# Autodesk Inventor assembly: base-roter
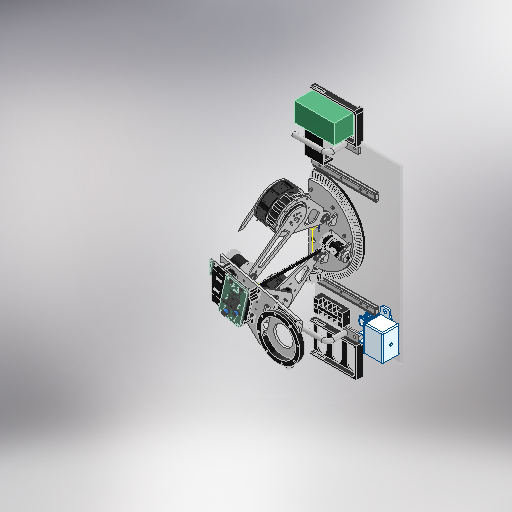
[picture p0: Inventor's stored thumbnail of the model, 512x512]
Saved by Autodesk Inventor 2025.3 (Build 293356030, 356C)
## iProperties
Created: 2026-02-11
Part Number: base-roter
Document SubType Name: Assembly
Designer: ibuki_ono
Author: ibuki_ono
## Documents named in this file (35)
- C:\Users\ibuki_ono\Documents\hobby\rogiken\catchrobo\2026_CAD\Hardware_2026\Inventor\base_table\base-roter.iam
- C:\Users\ibuki_ono\Documents\hobby\rogiken\catchrobo\2026_CAD\Hardware_2026\Inventor\base_table\gear\umbrella.iam
- C:\Users\ibuki_ono\Documents\hobby\rogiken\catchrobo\2026_CAD\Hardware_2026\Inventor\base_table\table_arm.iam
- C:\Users\ibuki_ono\Documents\hobby\rogiken\catchrobo\2026_CAD\Hardware_2026\Inventor\base_table\TOK_BEARING_101013DH16B1\101013 DH-16-B1.iam
- C:\Users\ibuki_ono\Documents\hobby\rogiken\catchrobo\2026_CAD\Hardware_2026\Inventor\base_table\AP5.0_base-roter.ipt
- C:\Users\ibuki_ono\Documents\hobby\rogiken\catchrobo\2026_CAD\Hardware_2026\Inventor\base_table\FL688ZZ.ipt
- C:\Users\ibuki_ono\Documents\hobby\rogiken\catchrobo\2026_CAD\Hardware_2026\Inventor\base_table\AP5.0_base-bearing-fix.ipt
- C:\Users\ibuki_ono\Documents\hobby\rogiken\catchrobo\2026_CAD\Hardware_2026\Inventor\base_table\AP5.0_motor-base.ipt
- C:\Users\ibuki_ono\Documents\hobby\rogiken\catchrobo\2026_CAD\Hardware_2026\Inventor\base_table\3D_GIM-fix.ipt
- C:\Users\ibuki_ono\Documents\hobby\rogiken\catchrobo\2026_CAD\Hardware_2026\Inventor\base_table\base_plate.ipt
- C:\Users\ibuki_ono\Documents\hobby\rogiken\catchrobo\2026_CAD\Hardware_2026\Inventor\base_table\AP2.0_base-roter-housing.ipt
- C:\Users\ibuki_ono\Documents\hobby\rogiken\catchrobo\2026_CAD\Hardware_2026\Inventor\base_table\AP5.0_base-bearing-fix-long.ipt
- C:\Users\ibuki_ono\Documents\hobby\rogiken\catchrobo\2026_CAD\Hardware_2026\Inventor\base_table\3D_outer-gear.ipt
- C:\Users\ibuki_ono\Documents\hobby\rogiken\catchrobo\2026_CAD\Hardware_2026\Inventor\base_table\AP10.0_com.ipt
- C:\Users\ibuki_ono\Documents\hobby\rogiken\catchrobo\2026_CAD\Hardware_2026\Inventor\base_table\UDP_w5500\UDP_w5500\UDP_w5500.iam
- C:\Users\ibuki_ono\Documents\hobby\rogiken\catchrobo\2026_CAD\Hardware_2026\Inventor\base_table\AS5600\AS5600.ipt
- C:\Users\ibuki_ono\Documents\hobby\rogiken\catchrobo\2026_CAD\Hardware_2026\Inventor\base_table\3D_roter-encoder.ipt
- C:\Users\ibuki_ono\Documents\hobby\rogiken\catchrobo\2026_CAD\Hardware_2026\Inventor\circuit\TE_relay.ipt
- C:\Users\ibuki_ono\Documents\hobby\rogiken\catchrobo\2026_CAD\Hardware_2026\Inventor\circuit\LiPo6cell.ipt
- C:\Users\ibuki_ono\Documents\hobby\rogiken\catchrobo\2026_CAD\Hardware_2026\Inventor\base_table\C-SRY20250\C-SRY20250.iam
- C:\Users\ibuki_ono\Documents\hobby\rogiken\catchrobo\2026_CAD\Hardware_2026\Inventor\circuit\IntelRealsense_D435_Multibody\IntelRealsense_D435_Multibody\IntelRealsense_D435_Multibody.ipt
- C:\Users\ibuki_ono\Documents\hobby\rogiken\catchrobo\2026_CAD\Hardware_2026\Inventor\base_table\AP3.0_E-STOP-camera.ipt
- C:\Users\ibuki_ono\Documents\hobby\rogiken\catchrobo\2026_CAD\Hardware_2026\Inventor\circuit\EmergencyStop.ipt
- C:\Users\ibuki_ono\Documents\hobby\rogiken\catchrobo\2026_CAD\Hardware_2026\Inventor\base_table\3D_Estop-mount.ipt
- C:\Users\ibuki_ono\Documents\hobby\rogiken\catchrobo\2026_CAD\Hardware_2026\Inventor\circuit\terminal.ipt
- C:\Users\ibuki_ono\Documents\hobby\rogiken\catchrobo\2026_CAD\Hardware_2026\Inventor\base_table\RoboMaster M2006 P36直流无刷减速电机\RoboMaster M2006 P36直流无刷减速电机.ipt
- C:\Users\ibuki_ono\Documents\hobby\rogiken\catchrobo\2026_CAD\Hardware_2026\Inventor\base_table\AP5.0_robomaster-fix.ipt
- C:\Users\ibuki_ono\Documents\hobby\rogiken\catchrobo\2026_CAD\Hardware_2026\Inventor\base_table\AP5.0_D-fix-A.ipt
- C:\Users\ibuki_ono\Documents\hobby\rogiken\catchrobo\2026_CAD\Hardware_2026\Inventor\base_table\3D_LiPo-holder.ipt
- C:\Users\ibuki_ono\Documents\hobby\rogiken\catchrobo\2026_CAD\Hardware_2026\Inventor\base_table\carbon-fai10-330mm.ipt
- C:\Users\ibuki_ono\Documents\hobby\rogiken\catchrobo\2026_CAD\Hardware_2026\Inventor\base_table\3D_carbon_mount-base.ipt
- C:\Users\ibuki_ono\Documents\hobby\rogiken\catchrobo\2026_CAD\Hardware_2026\Inventor\base_table\3D_realsense-mount.ipt
- C:\Users\ibuki_ono\Documents\hobby\rogiken\catchrobo\2026_CAD\Hardware_2026\Inventor\base_table\3D_circuit-mount.ipt
- C:\Users\ibuki_ono\Documents\hobby\rogiken\catchrobo\2026_CAD\Hardware_2026\Inventor\base_table\UWANSS160_Inventor\UWANSS160.ipt
- C:\Users\ibuki_ono\Documents\hobby\rogiken\catchrobo\2026_CAD\Hardware_2026\Inventor\base_table\3D_LAN-switch.ipt
## Components (62 placed, 34 different names)
1. umbrella:1 [sub-assembly] — メイト:17, 挿入:56, 挿入:57, メイト:27, 挿入:66, 挿入:67
2. 101013 DH-16-B1:1 [sub-assembly] — 挿入:6
3. 101013 DH-16-B1:2 [sub-assembly] — 挿入:5
4. AP5.0_base-roter:1 — 挿入:5, 挿入:6, 挿入:7, 挿入:8, 挿入:11, 挿入:12, 挿入:17, 挿入:18, 挿入:19, 挿入:20, 挿入:41, 挿入:42, 挿入:43, 挿入:44, 挿入:45, 挿入:46, メイト:17, 角度:1, 挿入:75, 挿入:76, 挿入:89, 挿入:90
5. AP5.0_base-bearing-fix:1 — 挿入:7, 挿入:8, メイト:14, 挿入:55
6. AP5.0_base-bearing-fix:2 — 挿入:11, 挿入:12
7. AP5.0_base-bearing-fix:3 — 挿入:17, 挿入:18, メイト:13
8. AP5.0_base-bearing-fix:4 — 挿入:19, 挿入:20
9. table_arm:3 [sub-assembly] — 挿入:31, 挿入:32, 挿入:33, 挿入:34, 挿入:65
10. FL688ZZ:7 — 挿入:32, メイト:26
11. FL688ZZ:8 — 挿入:34, メイト:14, 挿入:55
12. FL688ZZ:9 — 挿入:31, メイト:20, 挿入:62
13. FL688ZZ:10 — 挿入:33
14. table_arm:4 [sub-assembly] — メイト:24, 挿入:64
15. FL688ZZ:11
16. FL688ZZ:12 — メイト:13
17. FL688ZZ:13 — メイト:19, 挿入:63
18. FL688ZZ:14
19. 101013 DH-16-B1:5 [sub-assembly] — 挿入:41
20. 101013 DH-16-B1:6 [sub-assembly] — 挿入:42, メイト:18, 正接:1
21. 101013 DH-16-B1:7 [sub-assembly] — 挿入:43
22. 101013 DH-16-B1:8 [sub-assembly] — 挿入:45
23. 101013 DH-16-B1:9 [sub-assembly] — 挿入:46, 正接:2
24. 101013 DH-16-B1:10 [sub-assembly] — 挿入:44
25. AP5.0_motor-base:1 — 挿入:51, 挿入:52, 挿入:53, 挿入:54, 挿入:58, 挿入:59, 挿入:60, 挿入:61, 角度:1, 挿入:115, 挿入:116
26. 3D_GIM-fix:1 — 挿入:53, 挿入:54
27. 3D_GIM-fix:2 — 挿入:51, 挿入:52
28. base_plate:1 — メイト:27, 挿入:66, 挿入:67, 挿入:68, 挿入:69, 挿入:70, 挿入:71, メイト:28, メイト:29, フラッシュ:1, 挿入:77, 挿入:78, メイト:35, 挿入:81, 挿入:82, 挿入:83, 挿入:84, メイト:36, 角度:3, 挿入:111, 挿入:112, 挿入:113, 挿入:114, 挿入:121, 挿入:122, 挿入:125, 挿入:126
29. AP2.0_base-roter-housing:1 — メイト:18, 正接:1, 正接:2, 挿入:56, 挿入:57
30. AP5.0_base-bearing-fix-long:1 — 挿入:58, 挿入:59, メイト:19, メイト:22, 挿入:63
31. AP5.0_base-bearing-fix-long:2 — 挿入:60, 挿入:61, メイト:20, 挿入:62
32. 3D_outer-gear:2 — メイト:22, メイト:24, 挿入:64
33. 3D_outer-gear:3 — メイト:26, 挿入:65
34. AP10.0_com:1 — 挿入:68, 挿入:69
35. AP10.0_com:2 — 挿入:70, 挿入:71
36. AS5600:1 — 挿入:75, 挿入:76
37. 3D_roter-encoder:1 — 挿入:77, 挿入:78
38. TE_relay:1 — メイト:35, 挿入:111, 挿入:112
39. C-SRY20250:1 [sub-assembly] — 挿入:81, 挿入:82
40. C-SRY20250:2 [sub-assembly] — 挿入:83, 挿入:84, 挿入:85, 角度:2
41. IntelRealsense_D435_Multibody:1 — 挿入:109, 挿入:110
42. AP3.0_E-STOP-camera:1 — 挿入:85, 角度:2, 挿入:86, 挿入:87, 挿入:101, 挿入:102, 挿入:104, 挿入:105
43. EmergencyStop:1 — 挿入:88
44. 3D_Estop-mount:1 — 挿入:86, 挿入:87, 挿入:88
45. LiPo6cell:1 — メイト:39, メイト:40, メイト:41
46. terminal:1 — メイト:36, 角度:3, 挿入:113, 挿入:114
47. RoboMaster M2006 P36直流无刷减速电机:1 — 挿入:91, 挿入:92, メイト:37, メイト:38
48. AP5.0_robomaster-fix:1 — 挿入:89, 挿入:90, 挿入:91, 挿入:92
49. AP5.0_D-fix-A:1 — メイト:37, メイト:38
50. 3D_LiPo-holder:1 — メイト:39, メイト:40, メイト:41, 挿入:127, 挿入:128
51. 3D_LiPo-holder:2 — 挿入:121, 挿入:122, 挿入:123, 挿入:124
52. carbon-fai10-330mm:1 — 挿入:106, 挿入:108
53. carbon-fai10-330mm:2 — 挿入:103, 挿入:107
54. 3D_carbon_mount-base:1 — 挿入:101, 挿入:102, 挿入:103
55. 3D_carbon_mount-base:2 — 挿入:104, 挿入:105, 挿入:106
56. 3D_realsense-mount:1 — 挿入:107, 挿入:108, 挿入:109, 挿入:110
57. UDP_w5500:1 [sub-assembly] — 挿入:117, 挿入:118
58. 3D_circuit-mount:1 — 挿入:115, 挿入:116, 挿入:117, 挿入:118, 挿入:119, 挿入:120
59. UDP_w5500:2 [sub-assembly] — 挿入:119, 挿入:120
60. UWANSS160:1 — 挿入:123, 挿入:124
61. 3D_LAN-switch:1 — 挿入:125, 挿入:126
62. UWANSS160:2 — 挿入:127, 挿入:128
## Relationships (114: Insert 89, Mate 19, Angle 3, Tangent 2, Flush 1)
- 挿入:5 [Insert]: 101013 DH-16-B1:2 ↔ AP5.0_base-roter:1
- 挿入:6 [Insert]: 101013 DH-16-B1:1 ↔ AP5.0_base-roter:1
- 挿入:7 [Insert]: AP5.0_base-roter:1 ↔ AP5.0_base-bearing-fix:1
- 挿入:8 [Insert]: AP5.0_base-roter:1 ↔ AP5.0_base-bearing-fix:1
- 挿入:11 [Insert]: AP5.0_base-roter:1 ↔ AP5.0_base-bearing-fix:2
- 挿入:12 [Insert]: AP5.0_base-roter:1 ↔ AP5.0_base-bearing-fix:2
- 挿入:17 [Insert]: AP5.0_base-roter:1 ↔ AP5.0_base-bearing-fix:3
- 挿入:18 [Insert]: AP5.0_base-roter:1 ↔ AP5.0_base-bearing-fix:3
- 挿入:19 [Insert]: AP5.0_base-roter:1 ↔ AP5.0_base-bearing-fix:4
- 挿入:20 [Insert]: AP5.0_base-roter:1 ↔ AP5.0_base-bearing-fix:4
- 挿入:31 [Insert]: table_arm:3 ↔ FL688ZZ:9
- 挿入:32 [Insert]: table_arm:3 ↔ FL688ZZ:7
- 挿入:33 [Insert]: table_arm:3 ↔ FL688ZZ:10
- 挿入:34 [Insert]: table_arm:3 ↔ FL688ZZ:8
- [Insert]: table_arm:4 ↔ FL688ZZ:13
- [Insert]: table_arm:4 ↔ FL688ZZ:11
- [Insert]: table_arm:4 ↔ FL688ZZ:14
- [Insert]: table_arm:4 ↔ FL688ZZ:12
- メイト:13 [Mate]: AP5.0_base-bearing-fix:3 ↔ FL688ZZ:12
- メイト:14 [Mate]: AP5.0_base-bearing-fix:1 ↔ FL688ZZ:8
- 挿入:41 [Insert]: AP5.0_base-roter:1 ↔ 101013 DH-16-B1:5
- 挿入:42 [Insert]: AP5.0_base-roter:1 ↔ 101013 DH-16-B1:6
- 挿入:43 [Insert]: AP5.0_base-roter:1 ↔ 101013 DH-16-B1:7
- 挿入:44 [Insert]: AP5.0_base-roter:1 ↔ 101013 DH-16-B1:10
- 挿入:45 [Insert]: AP5.0_base-roter:1 ↔ 101013 DH-16-B1:8
- 挿入:46 [Insert]: AP5.0_base-roter:1 ↔ 101013 DH-16-B1:9
- 挿入:51 [Insert]: AP5.0_motor-base:1 ↔ 3D_GIM-fix:2
- 挿入:52 [Insert]: AP5.0_motor-base:1 ↔ 3D_GIM-fix:2
- 挿入:53 [Insert]: AP5.0_motor-base:1 ↔ 3D_GIM-fix:1
- 挿入:54 [Insert]: AP5.0_motor-base:1 ↔ 3D_GIM-fix:1
- 挿入:55 [Insert] (6.5 mm): AP5.0_base-bearing-fix:1 ↔ FL688ZZ:8
- メイト:17 [Mate]: umbrella:1 ↔ AP5.0_base-roter:1
- メイト:18 [Mate] (0.05 mm): 101013 DH-16-B1:6 ↔ AP2.0_base-roter-housing:1
- 正接:1 [Tangent]: 101013 DH-16-B1:6 ↔ AP2.0_base-roter-housing:1
- 正接:2 [Tangent]: 101013 DH-16-B1:9 ↔ AP2.0_base-roter-housing:1
- 挿入:56 [Insert]: umbrella:1 ↔ AP2.0_base-roter-housing:1
- 挿入:57 [Insert]: umbrella:1 ↔ AP2.0_base-roter-housing:1
- 挿入:58 [Insert]: AP5.0_motor-base:1 ↔ AP5.0_base-bearing-fix-long:1
- 挿入:59 [Insert]: AP5.0_motor-base:1 ↔ AP5.0_base-bearing-fix-long:1
- メイト:19 [Mate]: FL688ZZ:13 ↔ AP5.0_base-bearing-fix-long:1
- 挿入:60 [Insert]: AP5.0_motor-base:1 ↔ AP5.0_base-bearing-fix-long:2
- 挿入:61 [Insert]: AP5.0_motor-base:1 ↔ AP5.0_base-bearing-fix-long:2
- メイト:20 [Mate]: FL688ZZ:9 ↔ AP5.0_base-bearing-fix-long:2
- 挿入:62 [Insert] (0.2 mm): FL688ZZ:9 ↔ AP5.0_base-bearing-fix-long:2
- メイト:22 [Mate]: AP5.0_base-bearing-fix-long:1 ↔ 3D_outer-gear:2
- メイト:24 [Mate]: table_arm:4 ↔ 3D_outer-gear:2
- 角度:1 [Angle] (0 deg): AP5.0_base-roter:1 ↔ AP5.0_motor-base:1
- 挿入:63 [Insert] (0.2 mm): FL688ZZ:13 ↔ AP5.0_base-bearing-fix-long:1
- 挿入:64 [Insert]: table_arm:4 ↔ 3D_outer-gear:2
- メイト:26 [Mate]: FL688ZZ:7 ↔ 3D_outer-gear:3
- 挿入:65 [Insert]: table_arm:3 ↔ 3D_outer-gear:3
- メイト:27 [Mate]: umbrella:1 ↔ base_plate:1
- 挿入:66 [Insert]: umbrella:1 ↔ base_plate:1
- 挿入:67 [Insert]: umbrella:1 ↔ base_plate:1
- 挿入:68 [Insert]: base_plate:1 ↔ AP10.0_com:1
- 挿入:69 [Insert]: base_plate:1 ↔ AP10.0_com:1
- 挿入:70 [Insert]: base_plate:1 ↔ AP10.0_com:2
- 挿入:71 [Insert]: base_plate:1 ↔ AP10.0_com:2
- メイト:28 [Mate]: base_plate:1
- メイト:29 [Mate]: base_plate:1
- フラッシュ:1 [Flush]: base_plate:1
- 挿入:75 [Insert] (2 mm): AP5.0_base-roter:1 ↔ AS5600:1
- 挿入:76 [Insert] (2 mm): AP5.0_base-roter:1 ↔ AS5600:1
- 挿入:77 [Insert]: base_plate:1 ↔ 3D_roter-encoder:1
- 挿入:78 [Insert]: base_plate:1 ↔ 3D_roter-encoder:1
- メイト:35 [Mate]: base_plate:1 ↔ TE_relay:1
- 挿入:81 [Insert]: base_plate:1 ↔ C-SRY20250:1
- 挿入:82 [Insert]: base_plate:1 ↔ C-SRY20250:1
- 挿入:83 [Insert]: base_plate:1 ↔ C-SRY20250:2
- 挿入:84 [Insert]: base_plate:1 ↔ C-SRY20250:2
- 挿入:85 [Insert]: C-SRY20250:2 ↔ AP3.0_E-STOP-camera:1
- 角度:2 [Angle] (-90 deg): C-SRY20250:2 ↔ AP3.0_E-STOP-camera:1
- 挿入:86 [Insert]: AP3.0_E-STOP-camera:1 ↔ 3D_Estop-mount:1
- 挿入:87 [Insert]: AP3.0_E-STOP-camera:1 ↔ 3D_Estop-mount:1
- 挿入:88 [Insert]: EmergencyStop:1 ↔ 3D_Estop-mount:1
- メイト:36 [Mate]: base_plate:1 ↔ terminal:1
- 挿入:89 [Insert]: AP5.0_base-roter:1 ↔ AP5.0_robomaster-fix:1
- 挿入:90 [Insert]: AP5.0_base-roter:1 ↔ AP5.0_robomaster-fix:1
- 挿入:91 [Insert]: RoboMaster M2006 P36直流无刷减速电机:1 ↔ AP5.0_robomaster-fix:1
- 挿入:92 [Insert]: RoboMaster M2006 P36直流无刷减速电机:1 ↔ AP5.0_robomaster-fix:1
- メイト:37 [Mate]: RoboMaster M2006 P36直流无刷减速电机:1 ↔ AP5.0_D-fix-A:1
- メイト:38 [Mate]: RoboMaster M2006 P36直流无刷减速电机:1 ↔ AP5.0_D-fix-A:1
- メイト:39 [Mate]: LiPo6cell:1 ↔ 3D_LiPo-holder:1
- メイト:40 [Mate] (8 mm): LiPo6cell:1 ↔ 3D_LiPo-holder:1
- メイト:41 [Mate] (12 mm): LiPo6cell:1 ↔ 3D_LiPo-holder:1
- 挿入:101 [Insert]: AP3.0_E-STOP-camera:1 ↔ 3D_carbon_mount-base:1
- 挿入:102 [Insert]: AP3.0_E-STOP-camera:1 ↔ 3D_carbon_mount-base:1
- 挿入:103 [Insert]: carbon-fai10-330mm:2 ↔ 3D_carbon_mount-base:1
- 挿入:104 [Insert]: AP3.0_E-STOP-camera:1 ↔ 3D_carbon_mount-base:2
- 挿入:105 [Insert]: AP3.0_E-STOP-camera:1 ↔ 3D_carbon_mount-base:2
- 挿入:106 [Insert]: carbon-fai10-330mm:1 ↔ 3D_carbon_mount-base:2
- 挿入:107 [Insert]: carbon-fai10-330mm:2 ↔ 3D_realsense-mount:1
- 挿入:108 [Insert]: carbon-fai10-330mm:1 ↔ 3D_realsense-mount:1
- 挿入:109 [Insert]: IntelRealsense_D435_Multibody:1 ↔ 3D_realsense-mount:1
- 挿入:110 [Insert]: IntelRealsense_D435_Multibody:1 ↔ 3D_realsense-mount:1
- 角度:3 [Angle] (90 deg): base_plate:1 ↔ terminal:1
- 挿入:111 [Insert]: base_plate:1 ↔ TE_relay:1
- 挿入:112 [Insert]: base_plate:1 ↔ TE_relay:1
- 挿入:113 [Insert]: base_plate:1 ↔ terminal:1
- 挿入:114 [Insert]: base_plate:1 ↔ terminal:1
- 挿入:115 [Insert]: AP5.0_motor-base:1 ↔ 3D_circuit-mount:1
- 挿入:116 [Insert]: AP5.0_motor-base:1 ↔ 3D_circuit-mount:1
- 挿入:117 [Insert]: UDP_w5500:1 ↔ 3D_circuit-mount:1
- 挿入:118 [Insert]: UDP_w5500:1 ↔ 3D_circuit-mount:1
- 挿入:119 [Insert]: 3D_circuit-mount:1 ↔ UDP_w5500:2
- 挿入:120 [Insert]: 3D_circuit-mount:1 ↔ UDP_w5500:2
- 挿入:121 [Insert]: base_plate:1 ↔ 3D_LiPo-holder:2
- 挿入:122 [Insert]: base_plate:1 ↔ 3D_LiPo-holder:2
- 挿入:123 [Insert]: 3D_LiPo-holder:2 ↔ UWANSS160:1
- 挿入:124 [Insert]: 3D_LiPo-holder:2 ↔ UWANSS160:1
- 挿入:125 [Insert]: base_plate:1 ↔ 3D_LAN-switch:1
- 挿入:126 [Insert]: base_plate:1 ↔ 3D_LAN-switch:1
- 挿入:127 [Insert]: 3D_LiPo-holder:1 ↔ UWANSS160:2
- 挿入:128 [Insert]: 3D_LiPo-holder:1 ↔ UWANSS160:2
## Named parameters: d66_d63 = 0 mm, d67_d64 = 0 mm, d68_d65 = 0 mm, d69_d62 = 0 mm
